# Autodesk Inventor assembly: MPU6050_Assembly
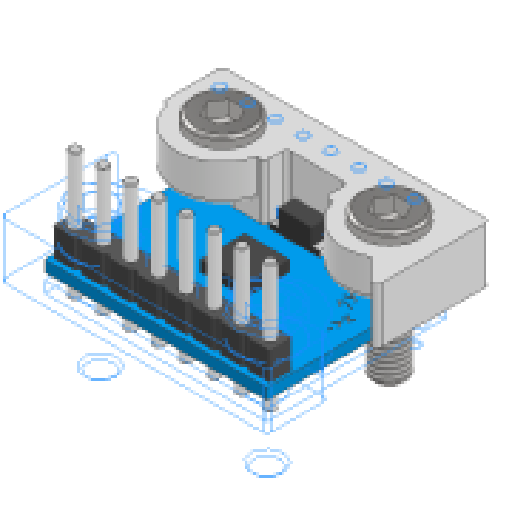
[picture p0: Inventor's stored thumbnail of the model, 512x512]
Saved by Autodesk Inventor 2025 (Build 290162000, 162)
## iProperties
Created: 2024-11-15
Part Number: MPU6050_Assembly
Document SubType Name: Assembly
Designer: OSB
Mass: 67.1055 g
Surface Area: 23.3098 cm^2
Volume: 1.3729 cm^3
Sending System: Autodesk Inventor 2021
Preprocessor: unknown
Minimum Resolution: 0.01
Sent Units: Millimeter
Translation Standard: IGES 5.3
Model Creation Time: 2020-07-07
Title: S500 Frame
Author: OSB
## Documents named in this file (5)
- C:\Users\OSB\Desktop\SB\1.Projects\캡스톤 디자인(2)_Paper\Modeling\Implementation_Design\Ver_004_mass_update\MPU6050_Assembly.iam
- C:\Users\OSB\Desktop\SB\1.Projects\캡스톤 디자인(2)_Paper\Modeling\Implementation_Design\Ver_004_mass_update\MPU6050_Sensor.ipt
- C:\Users\OSB\Desktop\SB\1.Projects\캡스톤 디자인(2)_Paper\Modeling\Implementation_Design\Ver_004_mass_update\MPU6050_Pin.ipt
- C:\Users\OSB\Desktop\SB\1.Projects\캡스톤 디자인(2)_Paper\Modeling\Implementation_Design\Ver_004_mass_update\MPU6050_Spacer.ipt
- C:\Users\OSB\Documents\Inventor\Content Center Files\R2025\ko-KR\KS B 1003\KS B 1003 - M 3 x 10.ipt
## Components (5 placed, 4 different names)
1. MPU6050_Sensor:1 — 회전:1, 메이트:1, 회전:2, 메이트:2
2. MPU6050_Pin:1 — 회전:1, 메이트:1
3. MPU6050_Spacer:1 — 회전:2, 메이트:2, 삽입:1, 삽입:2
4. KS B 1003 - 미터 M 3 x 10:1 — 삽입:1
5. KS B 1003 - 미터 M 3 x 10:2 — 삽입:2
## Relationships (6: RevoluteJoint 2, Mate 2, Insert 2)
- 회전:1 [RevoluteJoint]: MPU6050_Sensor:1 ↔ MPU6050_Pin:1
- 메이트:1 [Mate]: MPU6050_Sensor:1 ↔ MPU6050_Pin:1
- 회전:2 [RevoluteJoint]: MPU6050_Sensor:1 ↔ MPU6050_Spacer:1
- 메이트:2 [Mate]: MPU6050_Sensor:1 ↔ MPU6050_Spacer:1
- 삽입:1 [Insert]: MPU6050_Spacer:1 ↔ KS B 1003 - 미터 M 3 x 10:1
- 삽입:2 [Insert]: MPU6050_Spacer:1 ↔ KS B 1003 - 미터 M 3 x 10:2
